# Autodesk Inventor assembly: MN0542AN110_G03_002
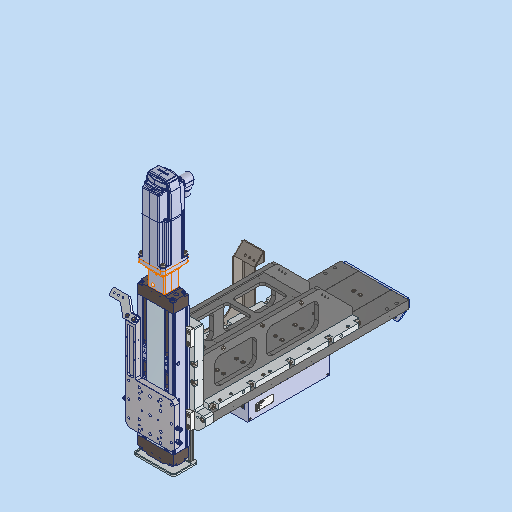
[picture p0: Inventor's stored thumbnail of the model, 512x512]
Saved by Autodesk Inventor 2023.3 (Build 273359000, 359)
## iProperties
RuleStatus: InUse
Created: 2021-01-21
Part Number: MN0542AN110_G03_002
Description: =<RBPARTNOTITLE2>
Document SubType Name: Assembly
Designer: ric7an
Mass: 11088.1 g
Surface Area: 27054.9 cm^2
Volume: 11088.1 cm^3
Density: 1 g/cm^3
AnP_Material: =<Material>
AnP_TemplVers: 20200821
RBDOCUMENTTYPE: DRF
RBDOCUMENTVERSION: 00
RBDRAWINGMAINSCALE: 1:1
RBDRAWINGMISSINGSPEC: --
RBDRAWINGVOLUME: --
RBDSV1: 0850
RBGBEDGESIN1: +0,5
RBGBEDGESIN2: +0,2
RBGBEDGESOUT1: -0,3
RBGBEDGESOUT2: -0,1
RBMATERIAL: =<Material>
RBMATMEETS: --
RBMATNO: =<Part Number>
RBPARTMADEOF: --
RBPARTNO: SIEHE MNR
RBPARTNOTITLE1: --
RBPARTSAFETYINDICATOR: --
RBSURFACE: --
RBSURFACE2: --
RBZEDGESNORM: ISO13715:2002-06
RBZGENDIMCLASS: m
RBZGENDIMNORM: ISO 2768-1:1989-11
RBZGENGEOCLASS: H
RBZGENGEONORM: ISO 2768-2:1989-11
RBZSURFACENORM: ISO13D2:2002-02
RBZTOLERANCENORM: ISO 14405-1:2010-12
Author: ric7an
Keywords: =<RBPARTMADEOF>
Comments: =<RBSURFACE2>
Revision Number: 01
## Documents named in this file (3)
- C:\Users\rea9an\Documents\Inventor\TCAI2412_te1910_EM\AS00000974.iam
- C:\Users\rea9an\Documents\Inventor\TCAI2412_te1910_EM\PT00004283.iam
- C:\Users\rea9an\Documents\Inventor\TCAI2412_te1910_EM\AS00000975.iam
## Components (2 placed, 2 different names)
1. PT00004283:1 [sub-assembly] — Fluchtend:1, Fluchtend:2, Passend:1, Passend:2, Passend:3, Fluchtend:3, Fluchtend:4
2. AS00000975:1 [sub-assembly] — Fluchtend:1, Fluchtend:2, Passend:1, Passend:2, Passend:3, Fluchtend:3, Fluchtend:4
## Relationships (7: Flush 4, Mate 3)
- Fluchtend:1 [Flush] (-1.3 mm): PT00004283:1 ↔ AS00000975:1
- Fluchtend:2 [Flush] (58 mm): PT00004283:1 ↔ AS00000975:1
- Passend:1 [Mate] (232 mm): PT00004283:1 ↔ AS00000975:1
- Passend:2 [Mate] (5.5 mm): PT00004283:1 ↔ AS00000975:1
- Passend:3 [Mate] (305.5 mm): PT00004283:1 ↔ AS00000975:1
- Fluchtend:3 [Flush] (204 mm): PT00004283:1 ↔ AS00000975:1
- Fluchtend:4 [Flush] (4 mm): PT00004283:1 ↔ AS00000975:1
